# Autodesk Inventor assembly: commutation_board
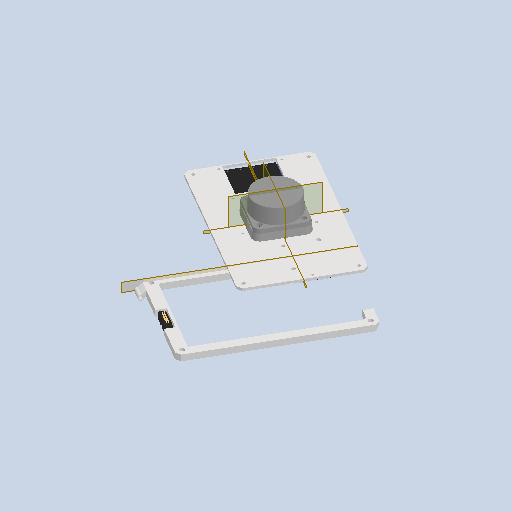
[picture p0: Inventor's stored thumbnail of the model, 512x512]
Saved by Autodesk Inventor 2025 (Build 290162000, 162)
## iProperties
Created: 2026-10-19
Part Number: commutation_board
Document SubType Name: Assembly
Designer: garin
Author: garin
## Documents named in this file (10)
- C:\Users\Leva\Documents\Git\TheseusV2_Maze\Construction\Theseus_v2\commutation_board\commutation_board.iam
- C:\Users\Leva\Documents\Git\TheseusV2_Maze\Construction\Theseus_v2\commutation_board\commutation_board.ipt
- C:\Users\Leva\Documents\Git\TheseusV2_Maze\Construction\Theseus_v2\commutation_board\1_5inch_oled_module.ipt
- C:\Users\Leva\Documents\Git\TheseusV2_Maze\Construction\Theseus_v2\commutation_board\Standoff mf - M2 x 5 across flats 4mm22.ipt
- C:\Users\Leva\Documents\Git\TheseusV2_Maze\Construction\Theseus_v2\LD19_v2.ipt
- C:\Users\Leva\Documents\Git\TheseusV2_Maze\Construction\Theseus_v2\commutation_board\Standoff mf - M2 x 8 across flats 4mm.ipt
- C:\Users\Leva\Documents\Git\TheseusV2_Maze\Construction\Theseus_v2\commutation_board\Heatsink+fan RPi-5.ipt
- C:\Users\Leva\Documents\Git\TheseusV2_Maze\Construction\Theseus_v2\commutation_board\cap.ipt
- C:\Users\Leva\Documents\Git\TheseusV2_Maze\Construction\Theseus_v2\commutation_board\1,5 in Oled v1.ipt
- C:\Users\Leva\Documents\Git\TheseusV2_Maze\Construction\Theseus_v2\commutation_board\CONB127P-2R-16W_TH.ipt
## Components (14 placed, 9 different names)
1. commutation_board:1 — Заподлицо:1, Совмещение:16, Совмещение:17, Совмещение:26, Совмещение:27, Заподлицо:2, Заподлицо:4, Заподлицо:5, Заподлицо:7, Совмещение:28, Угол:1, Совмещение:31, Заподлицо:8, Заподлицо:9
2. 1_5inch_oled_module:1 — Совмещение:18, Совмещение:19, Совмещение:20, Совмещение:21, Совмещение:22, Совмещение:23, Совмещение:24, Совмещение:25, Заподлицо:2, Заподлицо:3
3. Standoff mf - M2 x 5 across flats 4mm22:1 — Совмещение:20, Совмещение:23
4. Standoff mf - M2 x 5 across flats 4mm22:2 — Совмещение:19, Совмещение:24, Совмещение:26
5. Standoff mf - M2 x 5 across flats 4mm22:3 — Совмещение:21, Совмещение:22, Совмещение:29, Совмещение:30
6. Standoff mf - M2 x 5 across flats 4mm22:4 — Совмещение:18, Совмещение:25
7. LD19_v2:1 — Совмещение:10, Совмещение:11, Совмещение:12, Совмещение:13, Совмещение:14, Совмещение:15, Заподлицо:1, Совмещение:16
8. Standoff mf - M2 x 8 across flats 4mm:1 — Совмещение:10, Совмещение:15
9. Standoff mf - M2 x 8 across flats 4mm:2 — Совмещение:11, Совмещение:14, Заподлицо:3
10. Standoff mf - M2 x 8 across flats 4mm:3 — Совмещение:12, Совмещение:13, Совмещение:17
11. Heatsink+fan RPi-5:1 — Совмещение:27, Заподлицо:4, Заподлицо:5
12. cap:1 — Заподлицо:7, Совмещение:28
13. 1,5 in Oled v1:1 — Совмещение:29, Совмещение:30, Угол:1
14. CONB127P-2R-16W_TH:1 — Совмещение:31, Заподлицо:8, Заподлицо:9
## Relationships (31: Mate 22, Flush 8, Angle 1)
- Совмещение:10 [Mate]: LD19_v2:1 ↔ Standoff mf - M2 x 8 across flats 4mm:1
- Совмещение:11 [Mate]: LD19_v2:1 ↔ Standoff mf - M2 x 8 across flats 4mm:2
- Совмещение:12 [Mate]: LD19_v2:1 ↔ Standoff mf - M2 x 8 across flats 4mm:3
- Совмещение:13 [Mate]: LD19_v2:1 ↔ Standoff mf - M2 x 8 across flats 4mm:3
- Совмещение:14 [Mate]: LD19_v2:1 ↔ Standoff mf - M2 x 8 across flats 4mm:2
- Совмещение:15 [Mate]: LD19_v2:1 ↔ Standoff mf - M2 x 8 across flats 4mm:1
- Заподлицо:1 [Flush]: commutation_board:1 ↔ LD19_v2:1
- Совмещение:16 [Mate]: commutation_board:1 ↔ LD19_v2:1
- Совмещение:17 [Mate]: commutation_board:1 ↔ Standoff mf - M2 x 8 across flats 4mm:3
- Совмещение:18 [Mate]: 1_5inch_oled_module:1 ↔ Standoff mf - M2 x 5 across flats 4mm22:4
- Совмещение:19 [Mate]: 1_5inch_oled_module:1 ↔ Standoff mf - M2 x 5 across flats 4mm22:2
- Совмещение:20 [Mate]: 1_5inch_oled_module:1 ↔ Standoff mf - M2 x 5 across flats 4mm22:1
- Совмещение:21 [Mate]: 1_5inch_oled_module:1 ↔ Standoff mf - M2 x 5 across flats 4mm22:3
- Совмещение:22 [Mate]: 1_5inch_oled_module:1 ↔ Standoff mf - M2 x 5 across flats 4mm22:3
- Совмещение:23 [Mate]: 1_5inch_oled_module:1 ↔ Standoff mf - M2 x 5 across flats 4mm22:1
- Совмещение:24 [Mate]: 1_5inch_oled_module:1 ↔ Standoff mf - M2 x 5 across flats 4mm22:2
- Совмещение:25 [Mate]: 1_5inch_oled_module:1 ↔ Standoff mf - M2 x 5 across flats 4mm22:4
- Совмещение:26 [Mate]: commutation_board:1 ↔ Standoff mf - M2 x 5 across flats 4mm22:2
- Совмещение:27 [Mate]: commutation_board:1 ↔ Heatsink+fan RPi-5:1
- Заподлицо:2 [Flush]: commutation_board:1 ↔ 1_5inch_oled_module:1
- Заподлицо:3 [Flush] (5 mm): 1_5inch_oled_module:1 ↔ Standoff mf - M2 x 8 across flats 4mm:2
- Заподлицо:4 [Flush] (18 mm): commutation_board:1 ↔ Heatsink+fan RPi-5:1
- Заподлицо:5 [Flush] (10 mm): commutation_board:1 ↔ Heatsink+fan RPi-5:1
- Заподлицо:7 [Flush]: commutation_board:1 ↔ cap:1
- Совмещение:28 [Mate]: commutation_board:1 ↔ cap:1
- Совмещение:29 [Mate]: Standoff mf - M2 x 5 across flats 4mm22:3 ↔ 1,5 in Oled v1:1
- Совмещение:30 [Mate]: Standoff mf - M2 x 5 across flats 4mm22:3 ↔ 1,5 in Oled v1:1
- Угол:1 [Angle] (0 deg): commutation_board:1 ↔ 1,5 in Oled v1:1
- Совмещение:31 [Mate]: commutation_board:1 ↔ CONB127P-2R-16W_TH:1
- Заподлицо:8 [Flush] (1 mm): commutation_board:1 ↔ CONB127P-2R-16W_TH:1
- Заподлицо:9 [Flush] (31.09 mm): commutation_board:1 ↔ CONB127P-2R-16W_TH:1
